# Autodesk Inventor assembly: Assembly
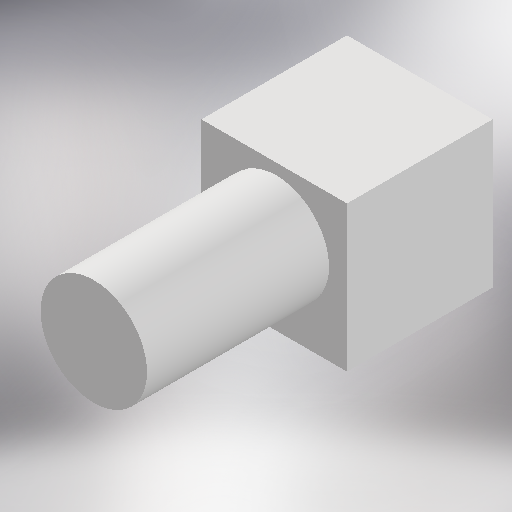
[picture p0: Inventor's stored thumbnail of the model, 512x512]
Saved by Autodesk Inventor 2026 (Build 300175000, 175)
## iProperties
Created: 2026-10-20
Part Number: Assembly
Document SubType Name: Assembly
Designer: 2ndlo
Author: 2ndlo
## Documents named in this file (3)
- P:\- A Teknisk Designer\TRYING TO LEARN\NEW\Assembly.iam
- P:\- A Teknisk Designer\TRYING TO LEARN\D - simple part.ipt
- P:\- A Teknisk Designer\TRYING TO LEARN\Cyl.ipt
## Components (2 placed, 2 different names)
1. D - simple part:1 — Mate:1
2. Cyl:1 — Mate:1
## Relationships (1: Mate 1)
- Mate:1: D - simple part:1 ↔ Cyl:1
